# Autodesk Inventor assembly: BOW ASSEMBLY
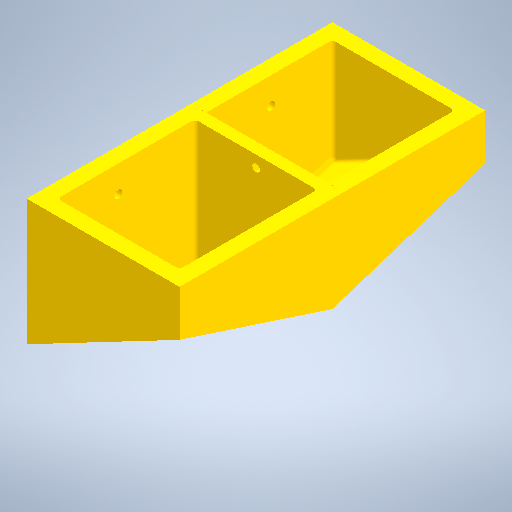
[picture p0: Inventor's stored thumbnail of the model, 512x512]
Saved by Autodesk Inventor 2026.2 (Build 302298000, 298)
## iProperties
Created: 2026-08-20
Part Number: BOW ASSEMBLY
Document SubType Name: Assembly
Designer: Taiye Raji
Mass: 1893.24 g
Surface Area: 5419.43 cm^2
Volume: 4782.11 cm^3
Density: 0.3959 g/cm^3
Author: Taiye Raji
## Documents named in this file (3)
- C:\Users\Taiye Raji\OneDrive - Stellenbosch University\Desktop\STELLENBOSCH UNIVERSITY MODULES\FOURTH YEAR MODULES\MECHATRONIC PROJECT\DRAWINGS\BOW ASSEMBLY.iam
- C:\Users\Taiye Raji\OneDrive - Stellenbosch University\Desktop\STELLENBOSCH UNIVERSITY MODULES\FOURTH YEAR MODULES\MECHATRONIC PROJECT\DRAWINGS\PART B.ipt
- C:\Users\Taiye Raji\OneDrive - Stellenbosch University\Desktop\STELLENBOSCH UNIVERSITY MODULES\FOURTH YEAR MODULES\MECHATRONIC PROJECT\DRAWINGS\PART A.ipt
## Components (2 placed, 2 different names)
1. PART B:1 — Mate:1, Mate:2, Flush:1
2. PART A:1 — Mate:1, Mate:2, Flush:1
## Relationships (3: Mate 2, Flush 1)
- Mate:1: PART B:1 ↔ PART A:1
- Mate:2: PART B:1 ↔ PART A:1
- Flush:1: PART B:1 ↔ PART A:1
